# Autodesk Inventor assembly: Base Model V2 Assembled
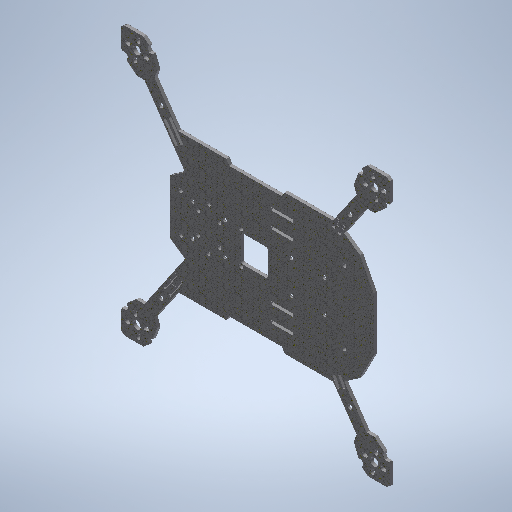
[picture p0: Inventor's stored thumbnail of the model, 512x512]
Saved by Autodesk Inventor 2025.2 (Build 292293000, 293)
## iProperties
Created: 2026-07-03
Part Number: Base Model V2 Assembled
Document SubType Name: Assembly
Designer: crazi
Author: crazi
## Documents named in this file (7)
- D:\Family\Arav\Projects\Drone\Chassis\Custom Chassis\Modelled\Base Model Split\Base Model V2 Assembled.iam
- D:\Family\Arav\Projects\Drone\Chassis\Custom Chassis\Modelled\Base Model Split\Base Model V2 Bottom Left.ipt
- D:\Family\Arav\Projects\Drone\Chassis\Custom Chassis\Modelled\Base Model Split\Base Model V2 Bottom Right.ipt
- D:\Family\Arav\Projects\Drone\Chassis\Custom Chassis\Modelled\Base Model Split\Base Model V2 Part 1.ipt
- D:\Family\Arav\Projects\Drone\Chassis\Custom Chassis\Modelled\Base Model Split\Base Model V2 Part2.ipt
- D:\Family\Arav\Projects\Drone\Chassis\Custom Chassis\Modelled\Base Model Split\Base Model V2 Top Left.ipt
- D:\Family\Arav\Projects\Drone\Chassis\Custom Chassis\Modelled\Base Model Split\Base Model V2 Top Right.ipt
## Components (6 placed, 6 different names)
1. Base Model V2 Bottom Left:1 — Mate:13, Mate:14, Mate:15
2. Base Model V2 Bottom Right:1 — Mate:10, Mate:11, Mate:12
3. Base Model V2 Part 1:1 — Mate:1, Mate:2, Mate:3, Mate:10, Mate:11, Mate:12, Mate:13, Mate:14, Mate:15
4. Base Model V2 Part2:1 — Mate:1, Mate:2, Mate:3, Mate:4, Mate:5, Mate:6, Mate:7, Mate:8, Mate:9
5. Base Model V2 Top Left:1 — Mate:4, Mate:5, Mate:6
6. Base Model V2 Top Right:1 — Mate:7, Mate:8, Mate:9
## Relationships (15: Mate 15)
- Mate:1: Base Model V2 Part 1:1 ↔ Base Model V2 Part2:1
- Mate:2: Base Model V2 Part 1:1 ↔ Base Model V2 Part2:1
- Mate:3: Base Model V2 Part 1:1 ↔ Base Model V2 Part2:1
- Mate:4: Base Model V2 Part2:1 ↔ Base Model V2 Top Left:1
- Mate:5: Base Model V2 Part2:1 ↔ Base Model V2 Top Left:1
- Mate:6: Base Model V2 Part2:1 ↔ Base Model V2 Top Left:1
- Mate:7: Base Model V2 Part2:1 ↔ Base Model V2 Top Right:1
- Mate:8: Base Model V2 Part2:1 ↔ Base Model V2 Top Right:1
- Mate:9: Base Model V2 Part2:1 ↔ Base Model V2 Top Right:1
- Mate:10: Base Model V2 Bottom Right:1 ↔ Base Model V2 Part 1:1
- Mate:11: Base Model V2 Bottom Right:1 ↔ Base Model V2 Part 1:1
- Mate:12: Base Model V2 Bottom Right:1 ↔ Base Model V2 Part 1:1
- Mate:13: Base Model V2 Bottom Left:1 ↔ Base Model V2 Part 1:1
- Mate:14: Base Model V2 Bottom Left:1 ↔ Base Model V2 Part 1:1
- Mate:15: Base Model V2 Bottom Left:1 ↔ Base Model V2 Part 1:1
